# Autodesk Inventor assembly: Clap-v1
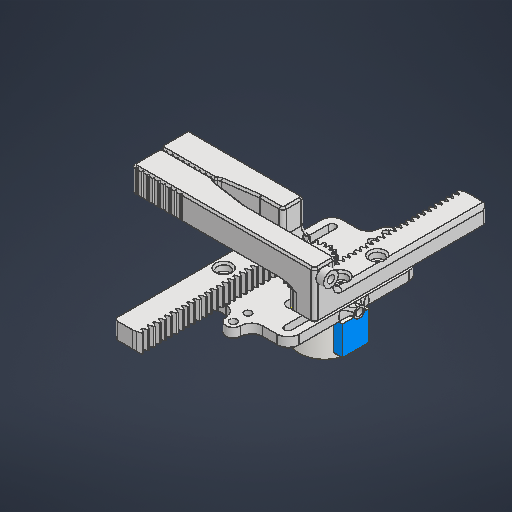
[picture p0: Inventor's stored thumbnail of the model, 512x512]
Saved by Autodesk Inventor 2026.2 (Build 302298010, 298A)
## iProperties
Created: 2026-05-01
Part Number: Clap-v1
Document SubType Name: Assembly
Designer: work
Author: work
## Documents named in this file (6)
- C:\Users\work\Desktop\ARD_v1\ARD_hardware\RA_Project\clap\Clap-v1.iam
- C:\Users\work\Desktop\ARD_v1\ARD_hardware\RA_Project\clap\moter_holder.ipt
- C:\Users\work\Desktop\ARD_v1\ARD_hardware\RA_Project\clap\Tongs_R.ipt
- C:\Users\work\Desktop\ARD_v1\ARD_hardware\RA_Project\clap\gear_M1.0_Z20_H10.0_O-0.10_spur.ipt
- C:\Users\work\Desktop\ARD_v1\ARD_hardware\RA_Project\28BJY-48.ipt
- C:\Users\work\Desktop\ARD_v1\ARD_hardware\RA_Project\clap\Tongs_L.ipt
## Components (5 placed, 5 different names)
1. moter_holder:1 — 메이트:2, 메이트:3, 메이트:5, 메이트:6, 각도:1, 플러쉬:1, 메이트:7, 메이트:8, 각도:2, 플러쉬:2
2. Tongs_R:1 — 메이트:6, 각도:1, 플러쉬:1
3. gear_M1.0_Z20_H10.0_O-0.10_spur:1 — 메이트:4, 메이트:5, 메이트:7
4. 28BJY-48:1 — 메이트:2, 메이트:3, 메이트:4
5. Tongs_L:1 — 메이트:8, 각도:2, 플러쉬:2
## Relationships (11: Mate 7, Angle 2, Flush 2)
- 메이트:2 [Mate]: moter_holder:1 ↔ 28BJY-48:1
- 메이트:3 [Mate]: moter_holder:1 ↔ 28BJY-48:1
- 메이트:4 [Mate]: gear_M1.0_Z20_H10.0_O-0.10_spur:1 ↔ 28BJY-48:1
- 메이트:5 [Mate]: moter_holder:1 ↔ gear_M1.0_Z20_H10.0_O-0.10_spur:1
- 메이트:6 [Mate]: moter_holder:1 ↔ Tongs_R:1
- 각도:1 [Angle] (0 deg): moter_holder:1 ↔ Tongs_R:1
- 플러쉬:1 [Flush] (-0.312 mm): moter_holder:1 ↔ Tongs_R:1
- 메이트:7 [Mate]: moter_holder:1 ↔ gear_M1.0_Z20_H10.0_O-0.10_spur:1
- 메이트:8 [Mate]: moter_holder:1 ↔ Tongs_L:1
- 각도:2 [Angle] (0 deg): moter_holder:1 ↔ Tongs_L:1
- 플러쉬:2 [Flush] (0.312 mm): moter_holder:1 ↔ Tongs_L:1
